# Autodesk Inventor assembly: 1.5_Base
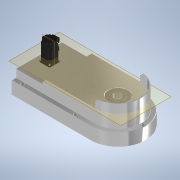
[picture p0: Inventor's stored thumbnail of the model, 180x180]
Saved by Autodesk Inventor 2021 (Build 250183000, 183)
## iProperties
Created: 2025-11-20
Part Number: 1.5_Base
Document SubType Name: Assembly
Designer: Admin
Mass: 33679.9 g
Surface Area: 11843.5 cm^2
Volume: 12044.6 cm^3
Density: 2.79627 g/cm^3
Author: Admin
## Documents named in this file (17)
- C:\Users\Admin\OneDrive - Politecnico di Milano\File di Erwin Rafael Novicio - Industrial Robotics SY 25-26\3D Model\COBOT - no shaftkeys\1.5_Base.iam
- C:\Users\Admin\OneDrive - Politecnico di Milano\File di Erwin Rafael Novicio - Industrial Robotics SY 25-26\3D Model\COBOT - no shaftkeys\1.5_1_MainBase.ipt
- C:\Users\Admin\OneDrive - Politecnico di Milano\File di Erwin Rafael Novicio - Industrial Robotics SY 25-26\3D Model\COBOT - no shaftkeys\BEARING_7310_BE-2RZP_2.ipt
- C:\Users\Admin\OneDrive - Politecnico di Milano\File di Erwin Rafael Novicio - Industrial Robotics SY 25-26\3D Model\COBOT - no shaftkeys\HG-MR23B-K.ipt
- C:\Users\Admin\OneDrive - Politecnico di Milano\File di Erwin Rafael Novicio - Industrial Robotics SY 25-26\3D Model\COBOT - no shaftkeys\1.5_2_MainBaseCover.ipt
- C:\Users\Admin\OneDrive - Politecnico di Milano\File di Erwin Rafael Novicio - Industrial Robotics SY 25-26\3D Model\COBOT - no shaftkeys\Timing_Pulley_22002-101620.ipt
- C:\Users\Admin\OneDrive - Politecnico di Milano\File di Erwin Rafael Novicio - Industrial Robotics SY 25-26\3D Model\COBOT - no shaftkeys\Timing_Pulley_22002-101640.ipt
- C:\Users\Admin\OneDrive - Politecnico di Milano\File di Erwin Rafael Novicio - Industrial Robotics SY 25-26\3D Model\COBOT - no shaftkeys\1.2_4_SpacerA.ipt
- C:\Users\Admin\Documents\Inventor\Content Center Files\R2021\en-US\ISO 4762(2)\ISO 4762 - M8 x 35ISO.ipt
- C:\Users\Admin\Documents\Inventor\Content Center Files\R2021\en-US\DIN 439-2\DIN 439 - M4 x 0.7.ipt
- C:\Users\Admin\Documents\Inventor\Content Center Files\R2021\en-US\DIN 555\DIN 555-5 - M4.ipt
- C:\Users\Admin\Documents\Inventor\Content Center Files\R2021\en-US\DIN 835\DIN 835 - M4 x 30 - 0.7.ipt
- C:\Users\Admin\OneDrive - Politecnico di Milano\File di Erwin Rafael Novicio - Industrial Robotics SY 25-26\3D Model\COBOT - no shaftkeys\1.5_3_SpacerA.ipt
- C:\Users\Admin\Documents\Inventor\Content Center Files\R2021\en-US\ISO 4762(2)\ISO 4762 - M5 x 20ISO.ipt
- C:\Users\Admin\OneDrive - Politecnico di Milano\File di Erwin Rafael Novicio - Industrial Robotics SY 25-26\3D Model\COBOT - no shaftkeys\1.5_4_SpacerB.ipt
- C:\Users\Admin\Documents\Inventor\Content Center Files\R2021\en-US\ISO 4762(2)\ISO 4762 - M6 x 35ISO.ipt
- C:\Users\Admin\OneDrive - Politecnico di Milano\File di Erwin Rafael Novicio - Industrial Robotics SY 25-26\3D Model\COBOT - no shaftkeys\TiminigBelt_G.ipt
## Components (27 placed, 16 different names)
1. 1.5_1_MainBase:1 — Flush:1, Flush:2, Flush:3, Mate:1, Mate:2, Mate:6, Mate:7, Mate:10, Mate:11, Mate:12, Mate:15, Mate:23, Mate:24, Mate:25, Mate:26, Mate:27, Mate:28, Mate:40, Angle:1
2. BEARING_7310_BE-2RZP_2:1 — Mate:1, Mate:2, Mate:55
3. HG-KR23B:1 — Mate:10, Mate:11, Mate:12, Mate:14, Mate:22, Mate:33, Mate:34, Mate:36, Mate:37, Mate:38, Mate:39
4. 1.5_2_MainBaseCover:1 — Mate:6, Mate:7, Mate:42, Mate:43
5. Timing_Pulley_22002-101620:1 — Mate:14, Flush:4, Mate:21, Mate:54
6. Timing_Pulley_22002-101640:1 — Flush:4, Mate:15, Mate:41, Angle:1, Mate:53, Mate:55
7. 1.2_4_SpacerA:1 — Mate:21, Mate:22, Mate:35
8. ISO 4762 M8 x 35:1 — Mate:23, Flush:5, Flush:6, Flush:8
9. ISO 4762 M8 x 35:2 — Flush:6, Flush:7, Mate:24
10. ISO 4762 M8 x 35:3 — Flush:8, Mate:25
11. ISO 4762 M8 x 35:4 — Flush:5, Mate:26
12. ISO 4762 M8 x 35:5 — Flush:7, Mate:27, Mate:28
13. DIN 835 M4 x 30:1 — Mate:33, Mate:34
14. DIN 439-2 - replaced by DIN EN 24035/28675 M4:1
15. DIN 555 - replaced by DIN EN 24034 M4:1 — Mate:35
16. 1.5_3_SpacerA:1 — Mate:36, Mate:37
17. 1.5_4_SpacerB:1 — Mate:40, Mate:41, Mate:44, Mate:45, Mate:46, Mate:47, Mate:48, Mate:49, Mate:50, Mate:51, Mate:52
18. BEARING_7310_BE-2RZP_2:2 — Mate:42, Mate:43
19. ISO 4762 M6 x 35:1 — Mate:46, Mate:52
20. ISO 4762 M6 x 35:2 — Mate:47, Mate:51
21. ISO 4762 M6 x 35:3 — Mate:48, Mate:49
22. ISO 4762 M6 x 35:4 — Mate:45, Mate:50
23. TiminigBelt_G:1 — Mate:53, Mate:54
24. ISO 4762 M5 x 20:1 — Mate:38, Mate:39
25. ISO 4762 M5 x 20:2
26. ISO 4762 M5 x 20:3
27. ISO 4762 M5 x 20:4
## Component patterns: (4 elements, first: ISO 4762 M5 x 20:1)
## Relationships (52: Mate 43, Flush 8, Angle 1)
- Flush:1: 1.5_1_MainBase:1
- Flush:2: 1.5_1_MainBase:1
- Flush:3: 1.5_1_MainBase:1
- Mate:1: 1.5_1_MainBase:1 ↔ BEARING_7310_BE-2RZP_2:1
- Mate:2: 1.5_1_MainBase:1 ↔ BEARING_7310_BE-2RZP_2:1
- Mate:6: 1.5_1_MainBase:1 ↔ 1.5_2_MainBaseCover:1
- Mate:7: 1.5_1_MainBase:1 ↔ 1.5_2_MainBaseCover:1
- Mate:10: 1.5_1_MainBase:1 ↔ HG-KR23B:1
- Mate:11: 1.5_1_MainBase:1 ↔ HG-KR23B:1
- Mate:12: 1.5_1_MainBase:1 ↔ HG-KR23B:1
- Mate:14: HG-KR23B:1 ↔ Timing_Pulley_22002-101620:1
- Flush:4: Timing_Pulley_22002-101620:1 ↔ Timing_Pulley_22002-101640:1
- Mate:15 (12 mm): 1.5_1_MainBase:1 ↔ Timing_Pulley_22002-101640:1
- Mate:21: Timing_Pulley_22002-101620:1 ↔ 1.2_4_SpacerA:1
- Mate:22: HG-KR23B:1 ↔ 1.2_4_SpacerA:1
- Mate:23: 1.5_1_MainBase:1 ↔ ISO 4762 M8 x 35:1
- Flush:5: ISO 4762 M8 x 35:1 ↔ ISO 4762 M8 x 35:4
- Flush:6: ISO 4762 M8 x 35:1 ↔ ISO 4762 M8 x 35:2
- Flush:7: ISO 4762 M8 x 35:2 ↔ ISO 4762 M8 x 35:5
- Flush:8: ISO 4762 M8 x 35:1 ↔ ISO 4762 M8 x 35:3
- Mate:24: 1.5_1_MainBase:1 ↔ ISO 4762 M8 x 35:2
- Mate:25: 1.5_1_MainBase:1 ↔ ISO 4762 M8 x 35:3
- Mate:26: 1.5_1_MainBase:1 ↔ ISO 4762 M8 x 35:4
- Mate:27: 1.5_1_MainBase:1 ↔ ISO 4762 M8 x 35:5
- Mate:28: 1.5_1_MainBase:1 ↔ ISO 4762 M8 x 35:5
- [Mate]: DIN 439-2 - replaced by DIN EN 24035/28675 M4:1 ↔ DIN 555 - replaced by DIN EN 24034 M4:1
- [Mate]: DIN 439-2 - replaced by DIN EN 24035/28675 M4:1 ↔ DIN 555 - replaced by DIN EN 24034 M4:1
- [Mate]: DIN 835 M4 x 30:1 ↔ DIN 439-2 - replaced by DIN EN 24035/28675 M4:1
- Mate:33: HG-KR23B:1 ↔ DIN 835 M4 x 30:1
- Mate:34 (-13 mm): HG-KR23B:1 ↔ DIN 835 M4 x 30:1
- Mate:35: 1.2_4_SpacerA:1 ↔ DIN 555 - replaced by DIN EN 24034 M4:1
- Mate:36: HG-KR23B:1 ↔ 1.5_3_SpacerA:1
- Mate:37: HG-KR23B:1 ↔ 1.5_3_SpacerA:1
- Mate:38: HG-KR23B:1 ↔ ISO 4762 M5 x 20:1
- Mate:39: HG-KR23B:1 ↔ ISO 4762 M5 x 20:1
- Mate:40: 1.5_1_MainBase:1 ↔ 1.5_4_SpacerB:1
- Mate:41: Timing_Pulley_22002-101640:1 ↔ 1.5_4_SpacerB:1
- Angle:1 (90 deg): 1.5_1_MainBase:1 ↔ Timing_Pulley_22002-101640:1
- Mate:42: 1.5_2_MainBaseCover:1 ↔ BEARING_7310_BE-2RZP_2:2
- Mate:43: 1.5_2_MainBaseCover:1 ↔ BEARING_7310_BE-2RZP_2:2
- Mate:44: 1.5_4_SpacerB:1
- Mate:45: 1.5_4_SpacerB:1 ↔ ISO 4762 M6 x 35:4
- Mate:46: 1.5_4_SpacerB:1 ↔ ISO 4762 M6 x 35:1
- Mate:47: 1.5_4_SpacerB:1 ↔ ISO 4762 M6 x 35:2
- Mate:48: 1.5_4_SpacerB:1 ↔ ISO 4762 M6 x 35:3
- Mate:49: 1.5_4_SpacerB:1 ↔ ISO 4762 M6 x 35:3
- Mate:50: 1.5_4_SpacerB:1 ↔ ISO 4762 M6 x 35:4
- Mate:51: 1.5_4_SpacerB:1 ↔ ISO 4762 M6 x 35:2
- Mate:52: 1.5_4_SpacerB:1 ↔ ISO 4762 M6 x 35:1
- Mate:53: Timing_Pulley_22002-101640:1 ↔ TiminigBelt_G:1
- Mate:54: Timing_Pulley_22002-101620:1 ↔ TiminigBelt_G:1
- Mate:55: BEARING_7310_BE-2RZP_2:1 ↔ Timing_Pulley_22002-101640:1
